# Autodesk Inventor assembly: MM0948AN100_G60_802
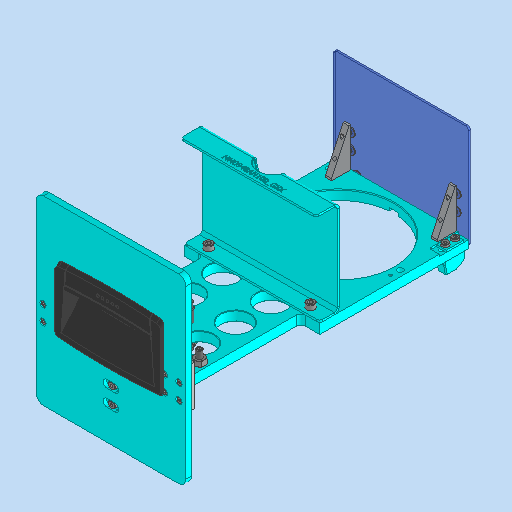
[picture p0: Inventor's stored thumbnail of the model, 512x512]
Saved by Autodesk Inventor 2023.3 (Build 273359000, 359)
## iProperties
RuleStatus: InUse
Created: 2023-03-23
Part Number: MM0948AN100_G60_802
Description: =<RBPARTNOTITLE2>
Document SubType Name: Assembly
Designer: FH/Wi
Mass: 1294.22 g
Surface Area: 2359.78 cm^2
Volume: 476.856 cm^3
Density: 2.71407 g/cm^3
AnP_Kategorie: 98
AnP_Material: =<Material>
AnP_TemplVers: 20200821
RBDOCUMENTTYPE: DRF
RBDOCUMENTVERSION: 00
RBDRAWINGMAINSCALE: 1:1
RBDRAWINGMISSINGSPEC: --
RBDRAWINGVOLUME: --
RBDSV1: 0850
RBGBEDGESIN1: +0,5
RBGBEDGESIN2: +0,2
RBGBEDGESOUT1: -0,3
RBGBEDGESOUT2: -0,1
RBMATERIAL: =<Material>
RBMATMEETS: --
RBMATNO: =<Part Number>
RBPARTMADEOF: --
RBPARTNO: SIEHE MNR
RBPARTNOTITLE1: enter description here
RBPARTNOTITLE2: hier Bezeichnung eintragen
RBPARTSAFETYINDICATOR: --
RBSURFACE: --
RBSURFACE2: --
RBZEDGESNORM: ISO13715:2002-06
RBZGENDIMCLASS: m
RBZGENDIMNORM: ISO 2768-1:1989-11
RBZGENGEOCLASS: H
RBZGENGEONORM: ISO 2768-2:1989-11
RBZSURFACENORM: ISO13D2:2002-02
RBZTOLERANCENORM: ISO 14405-1:2010-12
Author: FH/Wi
Keywords: =<RBPARTMADEOF>
Comments: =<RBSURFACE2>
Revision Number: 01
## Documents named in this file (23)
- C:\Users\rea9an\Documents\Inventor\TCAI2412_te1910_EM\AS00000941.iam
- C:\Users\rea9an\Documents\Inventor\TCAI2412_te1910_EM\PT00004603.ipt
- C:\Users\rea9an\Documents\Inventor\TCAI2412_te1910_EM\PT00004884.ipt
- C:\Users\rea9an\Documents\Inventor\TCAI2412_te1910_EM\PT00004869.ipt
- C:\Users\rea9an\Documents\Inventor\TCAI2412_te1910_EM\PT00004606.ipt
- C:\Users\rea9an\Documents\Inventor\TCAI2412_te1910_EM\PT00004843.ipt
- C:\Users\rea9an\Documents\Inventor\TCAI2412_te1910_EM\PT00004917.ipt
- C:\Users\rea9an\Documents\Inventor\TCAI2412_te1910_EM\PT00004455.ipt
- C:\Users\rea9an\Documents\Inventor\TCAI2412_te1910_EM\PT00004783.ipt
- C:\Users\rea9an\Documents\Inventor\TCAI2412_te1910_EM\PT00004610.ipt
- C:\Users\rea9an\Documents\Inventor\TCAI2412_te1910_EM\PT00004596.ipt
- C:\Users\rea9an\Documents\Inventor\TCAI2412_te1910_EM\PT00004451.ipt
- C:\Users\rea9an\Documents\Inventor\TCAI2412_te1910_EM\PT00004598.ipt
- C:\Users\rea9an\Documents\Inventor\TCAI2412_te1910_EM\PT00004450.ipt
- C:\Users\rea9an\Documents\Inventor\TCAI2412_te1910_EM\PT00004844.ipt
- C:\Users\rea9an\Documents\Inventor\TCAI2412_te1910_EM\PT00004840.ipt
- C:\Users\rea9an\Documents\Inventor\TCAI2412_te1910_EM\PT00004617.ipt
- C:\Users\rea9an\Documents\Inventor\TCAI2412_te1910_EM\PT00004820.ipt
- C:\Users\rea9an\Documents\Inventor\TCAI2412_te1910_EM\PT00004394.ipt
- C:\Users\rea9an\Documents\Inventor\TCAI2412_te1910_EM\PT00004597.ipt
- C:\Users\rea9an\Documents\Inventor\TCAI2412_te1910_EM\PT00004619.ipt
- C:\Users\rea9an\Documents\Inventor\TCAI2412_te1910_EM\PT00004388.ipt
- C:\Users\rea9an\Documents\Inventor\TCAI2412_te1910_EM\PT00004866.ipt
## Components (42 placed, 22 different names)
1. PT00004596:1 — Einfügen:19, Einfügen:20, Einfügen:21
2. PT00004597:1 — Passend:50, Passend:51, Passend:52, Passend:54, Einfügen:29, Einfügen:30
3. PT00004598:1
4. PT00004603:1
5. PT00004606:1
6. PT00004610:1
7. PT00004617:1 — Passend:49, Einfügen:27, Einfügen:28, Passend:53, Einfügen:31, Einfügen:32, Einfügen:33, Einfügen:34
8. PT00004394:1
9. PT00004820:1
10. PT00004619:1 — Passend:49, Passend:50, Passend:51
11. PT00004388:1 — Einfügen:27
12. PT00004388:2 — Einfügen:28
13. PT00004619:2 — Passend:52, Passend:53, Passend:54
14. PT00004866:1 — Einfügen:30
15. PT00004866:2 — Einfügen:29
16. PT00004388:3 — Einfügen:33
17. PT00004388:4 — Einfügen:34
18. PT00004388:5 — Einfügen:31
19. PT00004388:6 — Einfügen:32
20. PT00004917:1
21. PT00004884:3
22. PT00004884:2
23. PT00004783:2
24. PT00004869:3
25. PT00004783:1
26. PT00004869:2
27. PT00004843:1
28. PT00004843:2
29. PT00004840:8
30. PT00004840:7
31. PT00004840:6
32. PT00004840:5
33. PT00004840:4
34. PT00004840:3
35. PT00004840:2
36. PT00004840:1
37. PT00004844:2
38. PT00004844:1
39. PT00004455:1
40. PT00004451:1
41. PT00004450:1 — Einfügen:19
42. PT00004450:2 — Einfügen:20, Einfügen:21
## Relationships (70: Mate 40, Insert 27, Flush 3)
- [Mate]: PT00004597:1 ↔ PT00004603:1
- [Mate]: PT00004597:1 ↔ PT00004603:1
- [Mate]: PT00004597:1 ↔ PT00004603:1
- [Insert]: PT00004603:1 ↔ PT00004884:3
- [Insert]: PT00004603:1 ↔ PT00004884:2
- [Mate]: PT00004597:1 ↔ PT00004606:1
- [Mate]: PT00004606:1 ↔ PT00004843:1
- [Mate]: PT00004606:1 ↔ PT00004843:2
- [Mate]: PT00004597:1 ↔ PT00004606:1
- [Mate]: PT00004597:1 ↔ PT00004606:1
- [Mate]: PT00004597:1 ↔ PT00004606:1
- [Insert]: PT00004597:1 ↔ PT00004917:1
- [Mate] (6 mm): PT00004597:1 ↔ PT00004455:1
- [Insert]: PT00004783:1 ↔ PT00004869:2
- [Insert]: PT00004783:2 ↔ PT00004869:3
- [Mate]: PT00004597:1 ↔ PT00004783:2
- [Mate]: PT00004597:1 ↔ PT00004783:1
- [Mate]: PT00004610:1 ↔ PT00004843:2
- [Mate]: PT00004610:1 ↔ PT00004843:1
- [Mate]: PT00004610:1 ↔ PT00004843:1
- [Mate]: PT00004610:1 ↔ PT00004843:2
- [Mate]: PT00004597:1 ↔ PT00004610:1
- [Mate] (-24.5 mm): PT00004597:1 ↔ PT00004606:1
- [Mate]: PT00004597:1 ↔ PT00004455:1
- [Insert]: PT00004596:1 ↔ PT00004451:1
- [Mate]: PT00004596:1 ↔ PT00004451:1
- [Flush]: PT00004596:1 ↔ PT00004597:1
- [Mate] (3 mm): PT00004596:1 ↔ PT00004597:1
- [Mate]: PT00004597:1 ↔ PT00004598:1
- [Mate]: PT00004596:1 ↔ PT00004598:1
- [Flush] (64.5 mm): PT00004596:1 ↔ PT00004598:1
- [Mate]: PT00004596:1 ↔ PT00004598:1
- [Mate]: PT00004598:1 ↔ PT00004869:2
- [Mate]: PT00004598:1 ↔ PT00004869:3
- [Mate]: PT00004596:1 ↔ PT00004450:1
- [Mate]: PT00004596:1 ↔ PT00004450:1
- [Insert]: PT00004596:1 ↔ PT00004840:3
- [Insert]: PT00004596:1 ↔ PT00004840:1
- [Insert]: PT00004596:1 ↔ PT00004840:4
- [Insert]: PT00004596:1 ↔ PT00004840:2
- [Insert]: PT00004596:1 ↔ PT00004840:5
- [Insert]: PT00004596:1 ↔ PT00004840:7
- [Insert]: PT00004596:1 ↔ PT00004840:6
- [Insert]: PT00004596:1 ↔ PT00004840:8
- [Mate]: PT00004598:1 ↔ PT00004844:1
- [Mate]: PT00004598:1 ↔ PT00004844:2
- [Mate]: PT00004596:1 ↔ PT00004844:1
- [Mate]: PT00004596:1 ↔ PT00004844:2
- Einfügen:19 [Insert]: PT00004596:1 ↔ PT00004450:1
- Einfügen:20 [Insert]: PT00004596:1 ↔ PT00004450:2
- Einfügen:21 [Insert]: PT00004596:1 ↔ PT00004450:2
- [Insert]: PT00004597:1 ↔ PT00004617:1
- [Mate]: PT00004597:1 ↔ PT00004617:1
- [Mate]: PT00004597:1 ↔ PT00004394:1
- [Flush] (-2 mm): PT00004597:1 ↔ PT00004394:1
- [Insert]: PT00004597:1 ↔ PT00004820:1
- Passend:49 [Mate]: PT00004617:1 ↔ PT00004619:1
- Passend:50 [Mate]: PT00004597:1 ↔ PT00004619:1
- Einfügen:27 [Insert]: PT00004617:1 ↔ PT00004388:1
- Einfügen:28 [Insert]: PT00004617:1 ↔ PT00004388:2
- Passend:51 [Mate]: PT00004597:1 ↔ PT00004619:1
- Passend:52 [Mate]: PT00004597:1 ↔ PT00004619:2
- Passend:53 [Mate]: PT00004617:1 ↔ PT00004619:2
- Passend:54 [Mate]: PT00004597:1 ↔ PT00004619:2
- Einfügen:29 [Insert]: PT00004597:1 ↔ PT00004866:2
- Einfügen:30 [Insert]: PT00004597:1 ↔ PT00004866:1
- Einfügen:31 [Insert]: PT00004617:1 ↔ PT00004388:5
- Einfügen:32 [Insert]: PT00004617:1 ↔ PT00004388:6
- Einfügen:33 [Insert]: PT00004617:1 ↔ PT00004388:3
- Einfügen:34 [Insert]: PT00004617:1 ↔ PT00004388:4
